# Autodesk Inventor assembly: result-mate
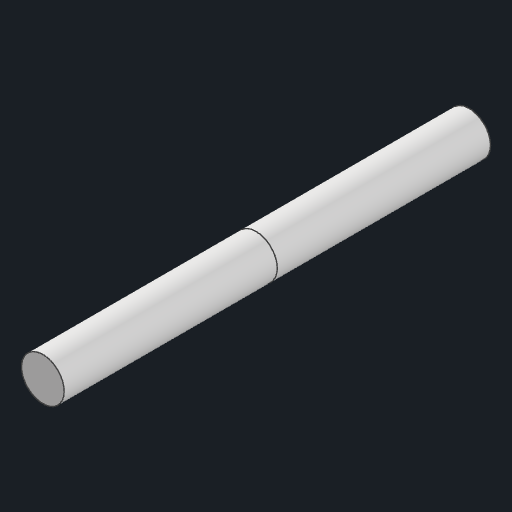
[picture p0: Inventor's stored thumbnail of the model, 512x512]
Saved by Autodesk Inventor 2026.1 (Build 301233000, 233)
## iProperties
Created: 2026-10-30
Part Number: result-mate
Document SubType Name: Assembly
Designer: anony
Author: anony
## Documents named in this file (2)
- C:\Users\anony\OneDrive\Desktop\AI Projects\CAD Convert\corpus\generated\asmimate\result-mate.iam
- C:\Users\anony\OneDrive\Desktop\AI Projects\CAD Convert\corpus\generated\imate\mate.ipt
## Components (2 placed, 1 different names)
1. mate:1 — Mate:1
2. mate:2 — Mate:1
## Relationships (1: Mate 1)
- Mate:1: mate:1 ↔ mate:2
